# Autodesk Inventor assembly: LCD_BEZEL
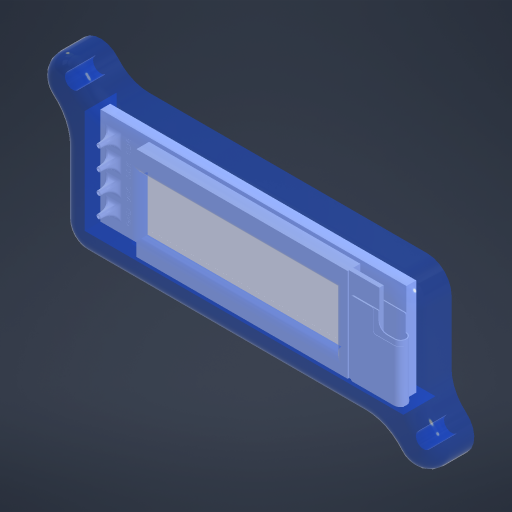
[picture p0: Inventor's stored thumbnail of the model, 512x512]
Saved by Autodesk Inventor 2024.3 (Build 283343000, 343)
## iProperties
Created: 2026-07-02
Part Number: LCD_BEZEL
Document SubType Name: Assembly
Designer: REMOTE
Author: REMOTE
## Documents named in this file (3)
- C:\Users\REMOTE\Desktop\RM-4_3D\LCD_BEZEL.iam
- C:\Users\REMOTE\Desktop\RM-4_3D\0.91in OLED.ipt
- C:\Users\REMOTE\Desktop\RM-4_3D\Frame_LCD.ipt
## Components (2 placed, 2 different names)
1. 0.91in OLED:1 — Flush:1
2. Frame_LCD:1 — Flush:1
## Relationships (1: Flush 1)
- Flush:1: 0.91in OLED:1 ↔ Frame_LCD:1
